# Autodesk Inventor assembly: Hop_co_servo
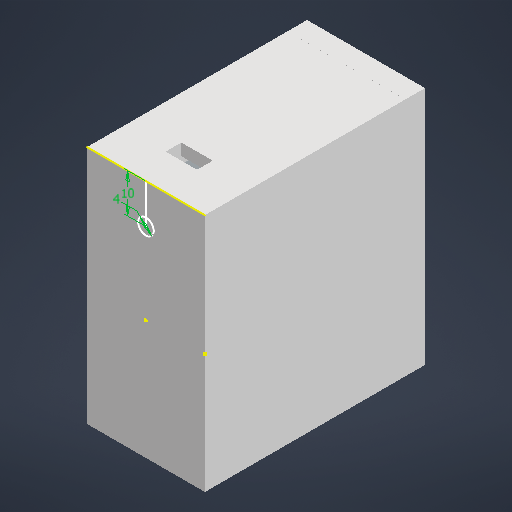
[picture p0: Inventor's stored thumbnail of the model, 512x512]
Saved by Autodesk Inventor 2027 (Build 310192060, 192F)
## iProperties
Created: 2026-04-03
Part Number: Hop_co_servo
Document SubType Name: Assembly
Designer: thita
Author: thita
## Documents named in this file (4)
- D:\Year2\đồ án tốt nghịp\servo-motor_8120mg-1.snapshot.2\Hop_co_servo.iam
- D:\Year2\đồ án tốt nghịp\servo-motor_8120mg-1.snapshot.2\Hộp khớp 2.ipt
- D:\Year2\đồ án tốt nghịp\servo-motor_8120mg-1.snapshot.2\nắp.ipt
- D:\Year2\đồ án tốt nghịp\servo-motor_8120mg-1.snapshot.2\Servo-9imod-DS35MG-180.ipt
## Components (3 placed, 3 different names)
1. Hộp khớp 2:1 — Rigid:1, Rigid:2
2. nắp:1 — Rigid:1
3. Servo-9imod-DS35MG-180:1 — Rigid:2
## Relationships (2: WeldJoint 2)
- Rigid:1 [WeldJoint]: Hộp khớp 2:1 ↔ nắp:1
- Rigid:2 [WeldJoint]: Hộp khớp 2:1 ↔ Servo-9imod-DS35MG-180:1
